# Autodesk Inventor assembly: D1-V1
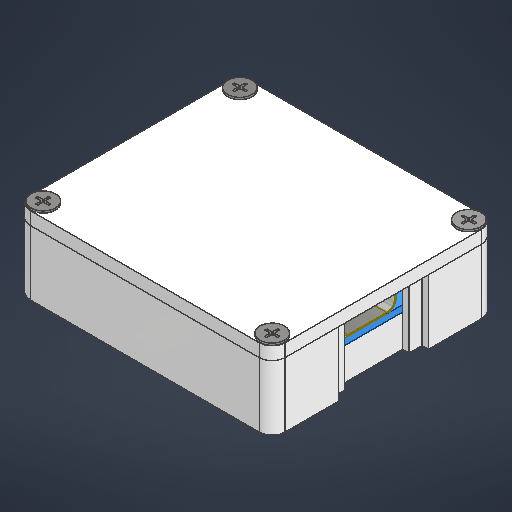
[picture p0: Inventor's stored thumbnail of the model, 512x512]
Saved by Autodesk Inventor 2027.1 (Build 311270010, 270A)
## iProperties
Created: 2026-09-25
Part Number: D1-V1
Document SubType Name: Assembly
Designer: work
Author: work
## Documents named in this file (5)
- C:\Users\work\Desktop\Mini WebServer\모델링\D1_V1\D1-V1.iam
- C:\Users\work\Desktop\Mini WebServer\모델링\D1_V1\D1 COVER.ipt
- C:\Users\work\Desktop\Mini WebServer\모델링\D1_V1\D1 CASE.ipt
- C:\Users\work\Desktop\Mini WebServer\모델링\D1_V1\ESP32-D1mini.ipt
- C:\Users\work\Desktop\Mini WebServer\모델링\D1_V1\JIS B 1122 - ST2.2 x 6.5 - C - H(1).ipt
## Components (7 placed, 4 different names)
1. D1 COVER:1 — 메이트:2, 메이트:3, 메이트:4, 삽입:1, 삽입:2, 삽입:3, 삽입:4
2. D1 CASE:1 — 메이트:1, 플러쉬:1, 접선:1, 메이트:2, 메이트:3, 메이트:4
3. ESP32-D1mini:1 — 메이트:1, 플러쉬:1, 접선:1
4. JIS B 1122 - ST2.2 x 6.5 - C - H(1):1 — 삽입:1
5. JIS B 1122 - ST2.2 x 6.5 - C - H(1):2 — 삽입:2
6. JIS B 1122 - ST2.2 x 6.5 - C - H(1):3 — 삽입:3
7. JIS B 1122 - ST2.2 x 6.5 - C - H(1):4 — 삽입:4
## Relationships (10: Mate 4, Insert 4, Flush 1, Tangent 1)
- 메이트:1 [Mate]: D1 CASE:1 ↔ ESP32-D1mini:1
- 플러쉬:1 [Flush]: D1 CASE:1 ↔ ESP32-D1mini:1
- 접선:1 [Tangent] (1 mm): D1 CASE:1 ↔ ESP32-D1mini:1
- 메이트:2 [Mate]: D1 COVER:1 ↔ D1 CASE:1
- 메이트:3 [Mate]: D1 COVER:1 ↔ D1 CASE:1
- 메이트:4 [Mate]: D1 COVER:1 ↔ D1 CASE:1
- 삽입:1 [Insert]: D1 COVER:1 ↔ JIS B 1122 - ST2.2 x 6.5 - C - H(1):1
- 삽입:2 [Insert]: D1 COVER:1 ↔ JIS B 1122 - ST2.2 x 6.5 - C - H(1):2
- 삽입:3 [Insert]: D1 COVER:1 ↔ JIS B 1122 - ST2.2 x 6.5 - C - H(1):3
- 삽입:4 [Insert]: D1 COVER:1 ↔ JIS B 1122 - ST2.2 x 6.5 - C - H(1):4
